# Autodesk Inventor assembly: jalusta_kokoonpano
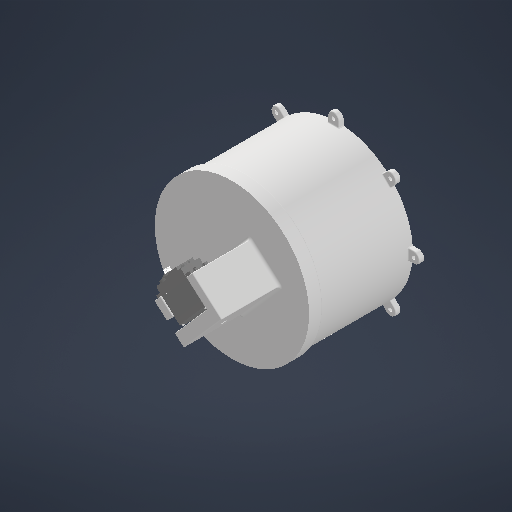
[picture p0: Inventor's stored thumbnail of the model, 512x512]
Saved by Autodesk Inventor 2027.1 (Build 311270010, 270A)
## iProperties
Created: 2025-09-24
Part Number: jalusta_kokoonpano
Document SubType Name: Assembly
Designer: amon-
Author: amon-
## iProperties of the stored document led.ipt
Created: 2014-01-03
Part Number: led
Material: Generic
Document SubType Name: Modeling
Designer: amon-
Density: 1 g/cm^3
Appearance: Default
Author: amon-
Revision Number: ANY
## iProperties of the stored document ATMEL328P.ipt
Created: 2014-01-03
Part Number: ATMEL328P
Material: Generic
Document SubType Name: Modeling
Designer: amon-
Density: 1 g/cm^3
Appearance: Default
Author: amon-
Revision Number: ANY
## iProperties of the stored document power jack.ipt
Created: 2014-01-03
Part Number: power jack
Material: Generic
Document SubType Name: Modeling
Designer: amon-
Density: 1 g/cm^3
Appearance: Default
Author: amon-
Revision Number: ANY
## iProperties of the stored document usb btm contact.ipt
Created: 2014-01-03
Part Number: usb btm contact
Material: Generic
Document SubType Name: Modeling
Designer: amon-
Density: 1 g/cm^3
Appearance: Default
Author: amon-
Revision Number: ANY
## iProperties of the stored document RESET CORE.ipt
Created: 2014-01-03
Part Number: RESET CORE
Material: Generic
Document SubType Name: Modeling
Designer: amon-
Density: 1 g/cm^3
Appearance: Default
Author: amon-
Revision Number: ANY
## iProperties of the stored document atmega16u2.ipt
Created: 2014-01-03
Part Number: atmega16u2
Material: Generic
Document SubType Name: Modeling
Designer: amon-
Density: 1 g/cm^3
Appearance: Default
Author: amon-
Revision Number: ANY
## iProperties of the stored document 16mhz crystal - measured.ipt
Created: 2014-01-03
Part Number: 16mhz crystal - measured
Material: Generic
Document SubType Name: Modeling
Designer: amon-
Density: 1 g/cm^3
Appearance: Default
Author: amon-
Revision Number: ANY
## iProperties of the stored document RESET BUTTON.iam
Created: 2014-01-03
Part Number: RESET BUTTON
Document SubType Name: Assembly
Designer: amon-
Author: amon-
Revision Number: ANY
## iProperties of the stored document mf-msmf050-2.ipt
Created: 2014-01-03
Part Number: mf-msmf050-2
Material: Generic
Document SubType Name: Modeling
Designer: amon-
Density: 1 g/cm^3
Appearance: Default
Author: amon-
Revision Number: ANY
## iProperties of the stored document USB core.ipt
Created: 2014-01-03
Part Number: USB core
Material: Generic
Document SubType Name: Modeling
Designer: amon-
Density: 1 g/cm^3
Appearance: Default
Author: amon-
Revision Number: ANY
## iProperties of the stored document blm21.ipt
Created: 2014-01-03
Part Number: blm21
Material: Generic
Document SubType Name: Modeling
Designer: amon-
Density: 1 g/cm^3
Appearance: Default
Author: amon-
Revision Number: ANY
## iProperties of the stored document RESET.ipt
Created: 2014-01-03
Part Number: RESET
Material: Generic
Document SubType Name: Modeling
Designer: amon-
Density: 1 g/cm^3
Appearance: Default
Author: amon-
Revision Number: ANY
## iProperties of the stored document 47uf CAP Dcase.ipt
Created: 2014-01-03
Part Number: 47uf CAP Dcase
Material: Generic
Document SubType Name: Modeling
Designer: amon-
Density: 1 g/cm^3
Appearance: Default
Author: amon-
Revision Number: ANY
## iProperties of the stored document lmv358.ipt
Created: 2014-01-03
Part Number: lmv358
Material: Generic
Document SubType Name: Modeling
Designer: amon-
Density: 1 g/cm^3
Appearance: Default
Author: amon-
Revision Number: ANY
## iProperties of the stored document 6 PORT HEADER.ipt
Created: 2014-01-03
Part Number: 6 PORT HEADER
Material: Generic
Document SubType Name: Modeling
Designer: amon-
Density: 1 g/cm^3
Appearance: Default
Author: amon-
Revision Number: ANY
## iProperties of the stored document dip28.ipt
Created: 2014-01-03
Part Number: dip28
Material: Generic
Document SubType Name: Modeling
Designer: amon-
Density: 1 g/cm^3
Appearance: Default
Author: amon-
Revision Number: ANY
## iProperties of the stored document arduino uno.iam
Created: 2014-01-03
Part Number: arduino uno
Description: STEP AP203
Document SubType Name: Assembly
Designer: amon-
Sending System: SolidWorks 2012
Preprocessor: SwSTEP 2.0
Title: arduino uno.STEP
Author: A
Revision Number: ANY
## iProperties of the stored document 103 RESISTOR PACK.ipt
Created: 2014-01-03
Part Number: 103 RESISTOR PACK
Material: Generic
Document SubType Name: Modeling
Designer: amon-
Density: 1 g/cm^3
Appearance: Default
Author: amon-
Revision Number: ANY
## iProperties of the stored document USB type b.SLDPRT.iam
Created: 2014-01-03
Part Number: USB type b.SLDPRT
Document SubType Name: Assembly
Designer: amon-
Author: amon-
Revision Number: ANY
## iProperties of the stored document 10 PORT HEADER.ipt
Created: 2014-01-03
Part Number: 10 PORT HEADER
Material: Generic
Document SubType Name: Modeling
Designer: amon-
Density: 1 g/cm^3
Appearance: Default
Author: amon-
Revision Number: ANY
## iProperties of the stored document ssot3.ipt
Created: 2014-01-03
Part Number: ssot3
Material: Generic
Document SubType Name: Modeling
Designer: amon-
Density: 1 g/cm^3
Appearance: Default
Author: amon-
Revision Number: ANY
## iProperties of the stored document 2pin_header__02.ipt
Created: 2014-01-03
Part Number: 2pin_header__02
Material: Generic
Document SubType Name: Modeling
Designer: amon-
Density: 1 g/cm^3
Appearance: Default
Author: amon-
Revision Number: ANY
## iProperties of the stored document 8 PORT HEADER.ipt
Created: 2014-01-03
Part Number: 8 PORT HEADER
Material: Generic
Document SubType Name: Modeling
Designer: amon-
Density: 1 g/cm^3
Appearance: Default
Author: amon-
Revision Number: ANY
## iProperties of the stored document lp2985dgkr.ipt
Created: 2014-01-03
Part Number: lp2985dgkr
Material: Generic
Document SubType Name: Modeling
Designer: amon-
Density: 1 g/cm^3
Appearance: Default
Author: amon-
Revision Number: ANY
## iProperties of the stored document 603 resistor.ipt
Created: 2014-01-03
Part Number: 603 resistor
Material: Generic
Document SubType Name: Modeling
Designer: amon-
Density: 1 g/cm^3
Appearance: Default
Author: amon-
Revision Number: ANY
## iProperties of the stored document m7 diode.ipt
Created: 2014-01-03
Part Number: m7 diode
Material: Generic
Document SubType Name: Modeling
Designer: amon-
Density: 1 g/cm^3
Appearance: Default
Author: amon-
Revision Number: ANY
## iProperties of the stored document usb top contact.ipt
Created: 2014-01-03
Part Number: usb top contact
Material: Generic
Document SubType Name: Modeling
Designer: amon-
Density: 1 g/cm^3
Appearance: Default
Author: amon-
Revision Number: ANY
## iProperties of the stored document PADS001.ipt
Created: 2014-01-03
Part Number: PADS001
Material: Generic
Document SubType Name: Modeling
Designer: amon-
Density: 1 g/cm^3
Appearance: Default
Author: amon-
Revision Number: ANY
## iProperties of the stored document 603 cap on pad.ipt
Created: 2014-01-03
Part Number: 603 cap on pad
Material: Generic
Document SubType Name: Modeling
Designer: amon-
Density: 1 g/cm^3
Appearance: Default
Author: amon-
Revision Number: ANY
## iProperties of the stored document MLC0603.ipt
Created: 2014-01-03
Part Number: MLC0603
Material: Generic
Document SubType Name: Modeling
Designer: amon-
Density: 1 g/cm^3
Appearance: Default
Author: amon-
Revision Number: ANY
## iProperties of the stored document nano - reg.ipt
Created: 2014-01-03
Part Number: nano - reg
Material: Generic
Document SubType Name: Modeling
Designer: amon-
Density: 1 g/cm^3
Appearance: Default
Author: amon-
Revision Number: ANY
## iProperties of the stored document crystal.ipt
Created: 2014-01-03
Part Number: crystal
Material: Generic
Document SubType Name: Modeling
Designer: amon-
Density: 1 g/cm^3
Appearance: Default
Author: amon-
Revision Number: ANY
## iProperties of the stored document 220 RESISTOR PACK.ipt
Created: 2014-01-03
Part Number: 220 RESISTOR PACK
Material: Generic
Document SubType Name: Modeling
Designer: amon-
Density: 1 g/cm^3
Appearance: Default
Author: amon-
Revision Number: ANY
## iProperties of the stored document USB SHELL.ipt
Created: 2014-01-03
Part Number: USB SHELL
Material: Generic
Document SubType Name: Modeling
Designer: amon-
Density: 1 g/cm^3
Appearance: Default
Author: amon-
Revision Number: ANY
## iProperties of the stored document cd1206 diode.ipt
Created: 2014-01-03
Part Number: cd1206 diode
Material: Generic
Document SubType Name: Modeling
Designer: amon-
Density: 1 g/cm^3
Appearance: Default
Author: amon-
Revision Number: ANY
## iProperties of the stored document dip socket pin.ipt
Created: 2014-01-03
Part Number: dip socket pin
Material: Generic
Document SubType Name: Modeling
Designer: amon-
Density: 1 g/cm^3
Appearance: Default
Author: amon-
Revision Number: ANY
## iProperties of the stored document dip28.iam
Created: 2014-01-03
Part Number: dip28
Document SubType Name: Assembly
Designer: amon-
Author: amon-
Revision Number: ANY
## iProperties of the stored document unoboard blue.ipt
Created: 2014-01-03
Part Number: unoboard blue
Material: Generic
Document SubType Name: Modeling
Designer: amon-
Density: 1 g/cm^3
Appearance: Default
Author: amon-
Revision Number: ANY
## iProperties of the stored document 102 RESISTOR PACK.ipt
Created: 2014-01-03
Part Number: 102 RESISTOR PACK
Material: Generic
Document SubType Name: Modeling
Designer: amon-
Density: 1 g/cm^3
Appearance: Default
Author: amon-
Revision Number: ANY
## Documents named in this file (46)
- C:\Users\nasra\Downloads\Arduino\KasiVarsi\.ipt .iam .step -tiedostot\jalusta_kokoonpano.iam
- C:\Users\nasra\Downloads\Arduino\KasiVarsi\.ipt .iam .step -tiedostot\Jalusta_kehä.ipt
- C:\Users\nasra\Downloads\Arduino\KasiVarsi\.ipt .iam .step -tiedostot\Jalusta_levy.ipt
- C:\Users\nasra\Downloads\Arduino\KasiVarsi\.ipt .iam .step -tiedostot\mg996_arm_4pad.ipt
- C:\Users\nasra\Downloads\Arduino\KasiVarsi\.ipt .iam .step -tiedostot\mg996R_v2.ipt
- **C:\Users\nasra\Downloads\Arduino\KasiVarsi\.ipt .iam .step -tiedostot\jalusta_kokoonpano.iam*LocalDocs*xAaaaqacaAaaaaaaaAaaaqbhaPa*arduino uno.iam
- C:\Users\nasra\Downloads\Arduino\KasiVarsi\.ipt .iam .step -tiedostot\arduino_alusta.ipt
- **C:\Users\nasra\Downloads\Arduino\KasiVarsi\.ipt .iam .step -tiedostot\jalusta_kokoonpano.iam*LocalDocs*xAaaaaraaAaaaaaaaAaaaqsdg0c*led.ipt
- **C:\Users\nasra\Downloads\Arduino\KasiVarsi\.ipt .iam .step -tiedostot\jalusta_kokoonpano.iam*LocalDocs*xAaaaafbaAaaaaaaaAaaaqxkhVe*ATMEL328P.ipt
- **C:\Users\nasra\Downloads\Arduino\KasiVarsi\.ipt .iam .step -tiedostot\jalusta_kokoonpano.iam*LocalDocs*xAaaaa3baAaaaaaaaAaaaas2pBg*power jack.ipt
- **C:\Users\nasra\Downloads\Arduino\KasiVarsi\.ipt .iam .step -tiedostot\jalusta_kokoonpano.iam*LocalDocs*xAaaaa1daAaaaaaaaAaaaqswxIa*usb btm contact.ipt
- **C:\Users\nasra\Downloads\Arduino\KasiVarsi\.ipt .iam .step -tiedostot\jalusta_kokoonpano.iam*LocalDocs*xAaaaa1baAaaaaaaaAaaaqcfgPe*RESET CORE.ipt
- **C:\Users\nasra\Downloads\Arduino\KasiVarsi\.ipt .iam .step -tiedostot\jalusta_kokoonpano.iam*LocalDocs*xAaaaa2aaAaaaaaaaAaaaalwj2d*atmega16u2.ipt
- **C:\Users\nasra\Downloads\Arduino\KasiVarsi\.ipt .iam .step -tiedostot\jalusta_kokoonpano.iam*LocalDocs*xAaaaa4caAaaaaaaaAaaaaka3Me*16mhz crystal - measured.ipt
- **C:\Users\nasra\Downloads\Arduino\KasiVarsi\.ipt .iam .step -tiedostot\jalusta_kokoonpano.iam*LocalDocs*xAaaaa3daAaaaaaaaAaaaq4d42f*RESET BUTTON.iam
- **C:\Users\nasra\Downloads\Arduino\KasiVarsi\.ipt .iam .step -tiedostot\jalusta_kokoonpano.iam*LocalDocs*xAaaaafdaAaaaaaaaAaaaqwpzKb*RESET.ipt
- **C:\Users\nasra\Downloads\Arduino\KasiVarsi\.ipt .iam .step -tiedostot\jalusta_kokoonpano.iam*LocalDocs*xAaaaaedaAaaaaaaaAaaaq4cuOh*mf-msmf050-2.ipt
- **C:\Users\nasra\Downloads\Arduino\KasiVarsi\.ipt .iam .step -tiedostot\jalusta_kokoonpano.iam*LocalDocs*xAaaaakcaAaaaaaaaAaaaaszlYe*USB core.ipt
- **C:\Users\nasra\Downloads\Arduino\KasiVarsi\.ipt .iam .step -tiedostot\jalusta_kokoonpano.iam*LocalDocs*xAaaaagbaAaaaaaaaAaaaazkj3e*blm21.ipt
- **C:\Users\nasra\Downloads\Arduino\KasiVarsi\.ipt .iam .step -tiedostot\jalusta_kokoonpano.iam*LocalDocs*xAaaaakaaAaaaaaaaAaaaade4Tc*47uf CAP Dcase.ipt
- **C:\Users\nasra\Downloads\Arduino\KasiVarsi\.ipt .iam .step -tiedostot\jalusta_kokoonpano.iam*LocalDocs*xAaaaamdaAaaaaaaaAaaaqhjy4a*lmv358.ipt
- **C:\Users\nasra\Downloads\Arduino\KasiVarsi\.ipt .iam .step -tiedostot\jalusta_kokoonpano.iam*LocalDocs*xAaaaakdaAaaaaaaaAaaaavozVg*6 PORT HEADER.ipt
- **C:\Users\nasra\Downloads\Arduino\KasiVarsi\.ipt .iam .step -tiedostot\jalusta_kokoonpano.iam*LocalDocs*xAaaaapdaAaaaaaaaAaaaq5ttAb*dip28.ipt
- **C:\Users\nasra\Downloads\Arduino\KasiVarsi\.ipt .iam .step -tiedostot\jalusta_kokoonpano.iam*LocalDocs*xAaaaqubaAaaaaaaaAaaaqriy3h*unoboard blue.ipt
- **C:\Users\nasra\Downloads\Arduino\KasiVarsi\.ipt .iam .step -tiedostot\jalusta_kokoonpano.iam*LocalDocs*xAaaaavaaAaaaaaaaAaaaq3j5Sa*USB type b.SLDPRT.iam
- **C:\Users\nasra\Downloads\Arduino\KasiVarsi\.ipt .iam .step -tiedostot\jalusta_kokoonpano.iam*LocalDocs*xAaaaqibaAaaaaaaaAaaaaw0zLf*crystal.ipt
- **C:\Users\nasra\Downloads\Arduino\KasiVarsi\.ipt .iam .step -tiedostot\jalusta_kokoonpano.iam*LocalDocs*xAaaaaycaAaaaaaaaAaaaqws2Qh*2pin_header__02.ipt
- **C:\Users\nasra\Downloads\Arduino\KasiVarsi\.ipt .iam .step -tiedostot\jalusta_kokoonpano.iam*LocalDocs*xAaaaqfaaAaaaaaaaAaaaqw4qUc*nano - reg.ipt
- **C:\Users\nasra\Downloads\Arduino\KasiVarsi\.ipt .iam .step -tiedostot\jalusta_kokoonpano.iam*LocalDocs*xAaaaqudaAaaaaaaaAaaaqtpcAg*dip28.iam
- **C:\Users\nasra\Downloads\Arduino\KasiVarsi\.ipt .iam .step -tiedostot\jalusta_kokoonpano.iam*LocalDocs*xAaaaaycaAaaaaaaaAaaaq4evPf*8 PORT HEADER.ipt
- **C:\Users\nasra\Downloads\Arduino\KasiVarsi\.ipt .iam .step -tiedostot\jalusta_kokoonpano.iam*LocalDocs*xAaaaaucaAaaaaaaaAaaaqjhnAg*10 PORT HEADER.ipt
- **C:\Users\nasra\Downloads\Arduino\KasiVarsi\.ipt .iam .step -tiedostot\jalusta_kokoonpano.iam*LocalDocs*xAaaaqydaAaaaaaaaAaaaqyab0f*102 RESISTOR PACK.ipt
- **C:\Users\nasra\Downloads\Arduino\KasiVarsi\.ipt .iam .step -tiedostot\jalusta_kokoonpano.iam*LocalDocs*xAaaaayaaAaaaaaaaAaaaaoy2Rh*103 RESISTOR PACK.ipt
- **C:\Users\nasra\Downloads\Arduino\KasiVarsi\.ipt .iam .step -tiedostot\jalusta_kokoonpano.iam*LocalDocs*xAaaaqpcaAaaaaaaaAaaaqm2j5g*220 RESISTOR PACK.ipt
- **C:\Users\nasra\Downloads\Arduino\KasiVarsi\.ipt .iam .step -tiedostot\jalusta_kokoonpano.iam*LocalDocs*xAaaaqddaAaaaaaaaAaaaab3lYf*PADS001.ipt
- **C:\Users\nasra\Downloads\Arduino\KasiVarsi\.ipt .iam .step -tiedostot\jalusta_kokoonpano.iam*LocalDocs*xAaaaqlaaAaaaaaaaAaaaapngMg*603 cap on pad.ipt
- **C:\Users\nasra\Downloads\Arduino\KasiVarsi\.ipt .iam .step -tiedostot\jalusta_kokoonpano.iam*LocalDocs*xAaaaawcaAaaaaaaaAaaaa4qi3f*ssot3.ipt
- **C:\Users\nasra\Downloads\Arduino\KasiVarsi\.ipt .iam .step -tiedostot\jalusta_kokoonpano.iam*LocalDocs*xAaaaazcaAaaaaaaaAaaaavkyNe*lp2985dgkr.ipt
- **C:\Users\nasra\Downloads\Arduino\KasiVarsi\.ipt .iam .step -tiedostot\jalusta_kokoonpano.iam*LocalDocs*xAaaaqqcaAaaaaaaaAaaaaqtwWh*cd1206 diode.ipt
- **C:\Users\nasra\Downloads\Arduino\KasiVarsi\.ipt .iam .step -tiedostot\jalusta_kokoonpano.iam*LocalDocs*xAaaaqebaAaaaaaaaAaaaqfa4Tg*603 resistor.ipt
- **C:\Users\nasra\Downloads\Arduino\KasiVarsi\.ipt .iam .step -tiedostot\jalusta_kokoonpano.iam*LocalDocs*xAaaaqdaaAaaaaaaaAaaaqtimGa*m7 diode.ipt
- **C:\Users\nasra\Downloads\Arduino\KasiVarsi\.ipt .iam .step -tiedostot\jalusta_kokoonpano.iam*LocalDocs*xAaaaqgdaAaaaaaaaAaaaahzwYe*MLC0603.ipt
- **C:\Users\nasra\Downloads\Arduino\KasiVarsi\.ipt .iam .step -tiedostot\jalusta_kokoonpano.iam*LocalDocs*xAaaaqocaAaaaaaaaAaaaax40Lg*USB SHELL.ipt
- **C:\Users\nasra\Downloads\Arduino\KasiVarsi\.ipt .iam .step -tiedostot\jalusta_kokoonpano.iam*LocalDocs*xAaaaqadaAaaaaaaaAaaaaa13Qf*usb top contact.ipt
- **C:\Users\nasra\Downloads\Arduino\KasiVarsi\.ipt .iam .step -tiedostot\jalusta_kokoonpano.iam*LocalDocs*xAaaaqqbaAaaaaaaaAaaaqaf0Ya*dip socket pin.ipt
- C:\Users\nasra\Downloads\Arduino\KasiVarsi\.ipt .iam .step -tiedostot\arduino uno.STEP
## Components (8 placed, 6 different names)
1. Jalusta_kehä:1 — Mate:6, Mate:7, Mate:8, Mate:9, Mate:11
2. mg996R_v2:1 — Mate:1, Rotational:1, Mate:6, Mate:7, Mate:8
3. mg996_arm_4pad:1 — Rotational:1, Rigid:1
4. Jalusta_levy:1 — Rigid:1, Mate:3, Mate:4, Mate:5
5. mg996R_v2:2 — Rotational:2, Mate:3, Mate:4, Mate:5
6. mg996_arm_4pad:2 — Rotational:2
7. arduino uno:1 [sub-assembly]
8. arduino_alusta:1 — Mate:9, Mate:11
## Relationships (12: Mate 9, RevoluteJoint 2, WeldJoint 1)
- Mate:1: mg996R_v2:1
- Rotational:1 [RevoluteJoint]: mg996R_v2:1 ↔ mg996_arm_4pad:1
- Rigid:1 [WeldJoint]: mg996_arm_4pad:1 ↔ Jalusta_levy:1
- Rotational:2 [RevoluteJoint]: mg996R_v2:2 ↔ mg996_arm_4pad:2
- Mate:3: Jalusta_levy:1 ↔ mg996R_v2:2
- Mate:4: Jalusta_levy:1 ↔ mg996R_v2:2
- Mate:5: Jalusta_levy:1 ↔ mg996R_v2:2
- Mate:6: Jalusta_kehä:1 ↔ mg996R_v2:1
- Mate:7: Jalusta_kehä:1 ↔ mg996R_v2:1
- Mate:8: Jalusta_kehä:1 ↔ mg996R_v2:1
- Mate:9: Jalusta_kehä:1 ↔ arduino_alusta:1
- Mate:11: Jalusta_kehä:1 ↔ arduino_alusta:1
